# Autodesk Inventor assembly: body_plus_tail
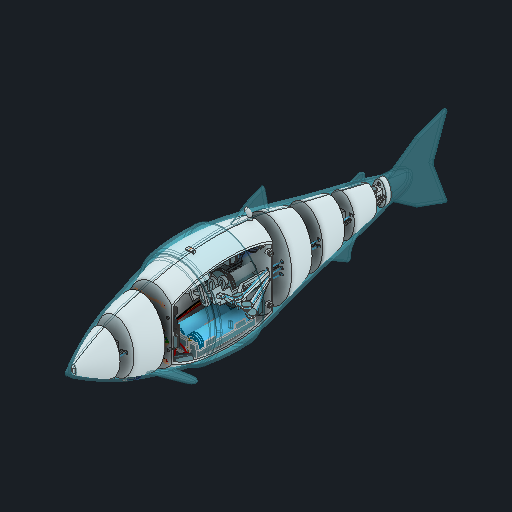
[picture p0: Inventor's stored thumbnail of the model, 512x512]
Saved by Autodesk Inventor 2026.1 (Build 301233020, 233B)
## iProperties
Created: 2025-11-26
Part Number: body_plus_tail
Document SubType Name: Assembly
Designer: maxbu
Author: maxbu
## Documents named in this file (50)
- C:\Users\caldi\Desktop\Magistrale\02_SECONDO ANNO\BIOINSPIRED ROBOTICS\PROJECT\3D_MODEL\B1_Fish_assembly.iam
- C:\Users\caldi\Desktop\Magistrale\02_SECONDO ANNO\BIOINSPIRED ROBOTICS\PROJECT\3D_MODEL\body.ipt
- C:\Users\caldi\Desktop\Magistrale\02_SECONDO ANNO\BIOINSPIRED ROBOTICS\PROJECT\3D_MODEL\wheel.ipt
- C:\Users\caldi\Desktop\Magistrale\02_SECONDO ANNO\BIOINSPIRED ROBOTICS\PROJECT\3D_MODEL\rod.ipt
- C:\Users\caldi\Desktop\Magistrale\02_SECONDO ANNO\BIOINSPIRED ROBOTICS\PROJECT\3D_MODEL\motor.ipt
- C:\Users\caldi\Desktop\Magistrale\02_SECONDO ANNO\BIOINSPIRED ROBOTICS\PROJECT\3D_MODEL\motor_gear.ipt
- C:\Users\caldi\Desktop\Magistrale\02_SECONDO ANNO\BIOINSPIRED ROBOTICS\PROJECT\3D_MODEL\pulley.ipt
- C:\Users\caldi\Desktop\Magistrale\02_SECONDO ANNO\BIOINSPIRED ROBOTICS\PROJECT\3D_MODEL\D_WIRES\wire1.ipt
- C:\Users\caldi\Desktop\Magistrale\02_SECONDO ANNO\BIOINSPIRED ROBOTICS\PROJECT\3D_MODEL\tail_segment_1.ipt
- C:\Users\caldi\Desktop\Magistrale\02_SECONDO ANNO\BIOINSPIRED ROBOTICS\PROJECT\3D_MODEL\tail_segment_2.ipt
- C:\Users\caldi\Desktop\Magistrale\02_SECONDO ANNO\BIOINSPIRED ROBOTICS\PROJECT\3D_MODEL\tail_segment_3.ipt
- C:\Users\caldi\Desktop\Magistrale\02_SECONDO ANNO\BIOINSPIRED ROBOTICS\PROJECT\3D_MODEL\tail_end_plate.ipt
- C:\Users\caldi\Desktop\Magistrale\02_SECONDO ANNO\BIOINSPIRED ROBOTICS\PROJECT\3D_MODEL\D_WIRES\wire3.ipt
- C:\Users\caldi\Desktop\Magistrale\02_SECONDO ANNO\BIOINSPIRED ROBOTICS\PROJECT\3D_MODEL\D_WIRES\wire3_aaaaa.ipt
- C:\Users\caldi\Desktop\Magistrale\02_SECONDO ANNO\BIOINSPIRED ROBOTICS\PROJECT\3D_MODEL\D_WIRES\wire4.ipt
- C:\Users\caldi\Desktop\Magistrale\02_SECONDO ANNO\BIOINSPIRED ROBOTICS\PROJECT\3D_MODEL\servo_motor.ipt
- C:\Users\caldi\Desktop\Magistrale\02_SECONDO ANNO\BIOINSPIRED ROBOTICS\PROJECT\3D_MODEL\spool.ipt
- C:\Users\caldi\Desktop\Magistrale\02_SECONDO ANNO\BIOINSPIRED ROBOTICS\PROJECT\3D_MODEL\D_WIRES\wire_servo.ipt
- C:\Users\caldi\Desktop\Magistrale\02_SECONDO ANNO\BIOINSPIRED ROBOTICS\PROJECT\3D_MODEL\servo_winding.ipt
- C:\Users\caldi\Desktop\Magistrale\02_SECONDO ANNO\BIOINSPIRED ROBOTICS\PROJECT\3D_MODEL\head_segment_2.ipt
- C:\Users\caldi\Desktop\Magistrale\02_SECONDO ANNO\BIOINSPIRED ROBOTICS\PROJECT\3D_MODEL\head_segment_1.ipt
- C:\Users\caldi\Desktop\Magistrale\02_SECONDO ANNO\BIOINSPIRED ROBOTICS\PROJECT\3D_MODEL\D_WIRES\wire2_1.ipt
- C:\Users\caldi\Desktop\Magistrale\02_SECONDO ANNO\BIOINSPIRED ROBOTICS\PROJECT\3D_MODEL\D_WIRES\wire2_2.ipt
- C:\Users\caldi\Desktop\Magistrale\02_SECONDO ANNO\BIOINSPIRED ROBOTICS\PROJECT\3D_MODEL\D_WIRES\wire2_3.ipt
- C:\Users\caldi\Desktop\Magistrale\02_SECONDO ANNO\BIOINSPIRED ROBOTICS\PROJECT\3D_MODEL\C_BatteryHolder3S\BatteryHolder3S.iam
- C:\Users\caldi\Desktop\Magistrale\02_SECONDO ANNO\BIOINSPIRED ROBOTICS\PROJECT\3D_MODEL\piston.ipt
- C:\Users\caldi\Desktop\Magistrale\02_SECONDO ANNO\BIOINSPIRED ROBOTICS\PROJECT\3D_MODEL\worm_gear.ipt
- C:\Users\caldi\Desktop\Magistrale\02_SECONDO ANNO\BIOINSPIRED ROBOTICS\PROJECT\3D_MODEL\piston_motor.ipt
- C:\Users\caldi\Desktop\Magistrale\02_SECONDO ANNO\BIOINSPIRED ROBOTICS\PROJECT\3D_MODEL\B_Sensors\BAR30-ASM-R2-PUBLIC\BAR30-ASM-R2-PUBLIC.ipt
- C:\Users\caldi\Desktop\Magistrale\02_SECONDO ANNO\BIOINSPIRED ROBOTICS\PROJECT\3D_MODEL\cylinder.ipt
- C:\Users\caldi\Desktop\Magistrale\02_SECONDO ANNO\BIOINSPIRED ROBOTICS\PROJECT\3D_MODEL\cylinder_head.ipt
- C:\Users\caldi\Desktop\Magistrale\02_SECONDO ANNO\BIOINSPIRED ROBOTICS\PROJECT\3D_MODEL\oring.ipt
- C:\Users\caldi\Desktop\Magistrale\02_SECONDO ANNO\BIOINSPIRED ROBOTICS\PROJECT\3D_MODEL\B_Sensors\Controllore_esp32-c6.ipt
- C:\Users\caldi\Desktop\Magistrale\02_SECONDO ANNO\BIOINSPIRED ROBOTICS\PROJECT\3D_MODEL\tail_end_for_animation.ipt
- C:\Users\caldi\Desktop\Magistrale\02_SECONDO ANNO\BIOINSPIRED ROBOTICS\PROJECT\3D_MODEL\cuscinetto_wheel.ipt
- C:\Users\caldi\Desktop\Magistrale\02_SECONDO ANNO\BIOINSPIRED ROBOTICS\PROJECT\3D_MODEL\ISO 1580 - M3 x 5_.ipt
- C:\Users\caldi\Desktop\Magistrale\02_SECONDO ANNO\BIOINSPIRED ROBOTICS\PROJECT\3D_MODEL\perni.ipt
- C:\Users\caldi\Desktop\Magistrale\02_SECONDO ANNO\BIOINSPIRED ROBOTICS\PROJECT\3D_MODEL\BS 3673_1 - S005M.ipt
- C:\Users\caldi\Desktop\Magistrale\02_SECONDO ANNO\BIOINSPIRED ROBOTICS\PROJECT\3D_MODEL\spring.ipt
- C:\Users\caldi\Desktop\Magistrale\02_SECONDO ANNO\BIOINSPIRED ROBOTICS\PROJECT\3D_MODEL\spring2.ipt
- C:\Users\caldi\Desktop\Magistrale\02_SECONDO ANNO\BIOINSPIRED ROBOTICS\PROJECT\3D_MODEL\tail_end_silicon.ipt
- C:\Users\caldi\Desktop\Magistrale\02_SECONDO ANNO\BIOINSPIRED ROBOTICS\PROJECT\3D_MODEL\silicon_skin.ipt
- C:\Users\caldi\Desktop\Magistrale\02_SECONDO ANNO\BIOINSPIRED ROBOTICS\PROJECT\3D_MODEL\Body_cover.ipt
- C:\Users\caldi\Desktop\Magistrale\02_SECONDO ANNO\BIOINSPIRED ROBOTICS\PROJECT\3D_MODEL\B_Sensors\sensoreTDS.ipt
- C:\Users\caldi\Desktop\Magistrale\02_SECONDO ANNO\BIOINSPIRED ROBOTICS\PROJECT\3D_MODEL\B_Sensors\pcb_TDS_sensor.ipt
- C:\Users\caldi\Desktop\Magistrale\02_SECONDO ANNO\BIOINSPIRED ROBOTICS\PROJECT\3D_MODEL\weight.ipt
- C:\Users\caldi\Desktop\Magistrale\02_SECONDO ANNO\BIOINSPIRED ROBOTICS\PROJECT\3D_MODEL\B_Sensors\MPU6050 Accelerometer_1.ipt
- C:\Users\caldi\Desktop\Magistrale\02_SECONDO ANNO\BIOINSPIRED ROBOTICS\PROJECT\3D_MODEL\B_Sensors\sensore_Temp.ipt
- C:\Users\caldi\Desktop\Magistrale\02_SECONDO ANNO\BIOINSPIRED ROBOTICS\PROJECT\3D_MODEL\viti_iso_2010-m2x10.ipt
- C:\Users\caldi\Desktop\Magistrale\02_SECONDO ANNO\BIOINSPIRED ROBOTICS\PROJECT\3D_MODEL\E_Cavi e cablaggi\Cablaggio1.iam
## Components (148 placed, 49 different names)
1. tail_end_silicon:1 — Flush:4, Flush:5, Flush:6
2. tail_end_for_animation:1 — Mate:122, Mate:123, Mate:124
3. silicon_skin:1 — Flush:7, Flush:8, Flush:9
4. viti_iso_2010-m2x10:1 — Mate:242, Mate:243
5. viti_iso_2010-m2x10:2 — Mate:244, Mate:245
6. Cablaggio1:1 [sub-assembly] — Mate:246
7. body:1 — Mate:1, Mate:2, Mate:4, Mate:5, Mate:8, Flush:1, Mate:18, Mate:19, Mate:20, Mate:21, Mate:25, Mate:26, Angle:1, Angle:2, Angle:3, Angle:4, Angle:5, Mate:37, Mate:38, Mate:39, Ball:15, Ball:16, Mate:42, Mate:43, Angle:8, Angle:9, Angle:10, Mate:50, Mate:51, Mate:52, Mate:53, Mate:54, Mate:55, Mate:57, Mate:58, Mate:59, Mate:60, Mate:68, Mate:69, Mate:72, Mate:73, Ball:26, Mate:97, Mate:98, Mate:99, Mate:102, Mate:103, Angle:11, Mate:113, Mate:114, Mate:115, Mate:120, Mate:121, Mate:125, Mate:146, Mate:168, Mate:169, Mate:176, Tangent:9, Mate:179, Tangent:10, Flush:4, Flush:5, Flush:6, Flush:7, Flush:8, Flush:9, Mate:200, Mate:201, Mate:202, Mate:203, Mate:205, Mate:207, Mate:212, Mate:213, Mate:214, Mate:215, Mate:216, Mate:217, Mate:218, Mate:219, Mate:221, Mate:222, Mate:223, Mate:224, Mate:226, Mate:230, Tangent:17, Mate:231, Tangent:18
8. Body_cover:1 — Mate:200, Mate:201, Mate:202, Mate:204, Mate:206, Mate:208
9. BatteryHolder3S:1 [sub-assembly] — Mate:97, Mate:98, Mate:99, Mate:144, Mate:145, Mate:147, Mate:246
10. Controllore_esp32-c6:1 — Mate:102, Mate:103, Angle:11, Mate:172, Mate:173
11. pcb_TDS_sensor:1 — Mate:212, Mate:213, Mate:214
12. MPU6050 Accelerometer_1:1 — Mate:221, Mate:222, Mate:223, Mate:225, Mate:227
13. weight:1
14. weight:2
15. weight:3
16. weight:4 — Mate:219, Mate:220, Flush:10, Flush:11
17. weight:5 — Mate:220, Flush:10, Flush:11
18. tail_end_plate:1 — Mate:31, Mate:32, Angle:5, Mate:122, Mate:123, Mate:124, Mate:166, Mate:167, Mate:194, Mate:195, Mate:242, Mate:243, Mate:244, Mate:245
19. perni:4 — Mate:160, Mate:161, Mate:166, Mate:167
20. BS 3673 : Parte 1 - Metrico S005M:6 — Mate:160, Mate:161
21. spring:8 — Mate:187, Tangent:16, Mate:199
22. spring:9 — Mate:186, Tangent:15, Mate:198
23. spring2:7 — Mate:194, Mate:199
24. spring2:8 — Mate:195, Mate:198
25. head_segment_2:1 — Mate:42, Mate:43, Angle:8, Mate:44, Mate:45, Ball:19, Ball:20, Ball:21, Ball:23, Mate:170, Mate:171, Mate:174, Mate:175, Mate:209, Mate:210, Mate:228, Mate:229, Mate:232, Mate:234, Mate:236, Tangent:19, Mate:237, Tangent:20
26. head_segment_1:1 — Mate:44, Mate:45, Angle:9, Mate:48, Mate:49, Mate:238, Mate:240
27. wire3:7 — Cylindrical:9, Ball:22
28. wire3:8 — Cylindrical:10, Ball:24
29. wire4:3 — Mate:49, Cylindrical:8
30. wire4:4 — Mate:48, Cylindrical:7
31. wire3_aaaaa:7 — Ball:19, Cylindrical:7
32. wire3_aaaaa:8 — Ball:20, Cylindrical:8
33. wire3_aaaaa:9 — Ball:21, Cylindrical:9
34. wire3_aaaaa:10 — Ball:23, Cylindrical:10
35. spring:10 — Mate:230, Tangent:17, Mate:233
36. spring:11 — Mate:231, Tangent:18, Mate:235
37. spring2:9 — Mate:232, Mate:233
38. spring2:10 — Mate:234, Mate:235
39. spring:12 — Mate:236, Tangent:19, Mate:239
40. spring:13 — Mate:237, Tangent:20, Mate:241
41. spring2:11 — Mate:238, Mate:239
42. spring2:12 — Mate:240, Mate:241
43. perni:5 — Mate:152, Mate:153, Mate:168, Mate:169
44. perni:6 — Mate:150, Mate:151, Mate:170, Mate:171
45. BS 3673 : Parte 1 - Metrico S005M:1 — Mate:150, Mate:151
46. BS 3673 : Parte 1 - Metrico S005M:2 — Mate:152, Mate:153
47. sensoreTDS:1 — Mate:209, Mate:210
48. BAR30-ASM-R2-PUBLIC:1 — Mate:174, Mate:175
49. sensore_Temp:1 — Mate:228, Mate:229
50. motor:1 — Mate:4, Mate:5, Mate:8, Mate:9, Mate:10, Mate:139, Mate:140, Mate:141, Mate:142, Mate:143
51. motor_gear:1 — Mate:9, Mate:10, Rotation:1
52. wheel:1 — Mate:1, Mate:2, Rotation:1, Tangent:3, Angle:1, Tangent:6, Tangent:7, Mate:126
53. cuscinetto_wheel:1 — Mate:125, Mate:126
54. ISO 1580 M3 x 5:1 — Mate:142, Mate:143
55. ISO 1580 M3 x 5:4 — Mate:139, Mate:140, Mate:141
56. servo_motor:1 — Mate:35, Mate:36, Mate:37, Mate:38, Mate:39, Angle:6, Angle:7, Mate:127, Mate:128, Mate:129, Mate:130
57. servo_winding — Mate:40, Mate:41
58. wire_servo:2 — Ball:16, Tangent:5, Angle:7, Ball:24
59. wire_servo:1 — Tangent:4, Ball:15, Angle:6, Ball:22
60. spool:1 — Mate:35, Mate:36, Tangent:4, Tangent:5, Mate:40, Mate:41, Angle:10
61. ISO 1580 M3 x 5:10 — Mate:127, Mate:128
62. ISO 1580 M3 x 5:9 — Mate:129, Mate:130
63. piston_motor:1 — Mate:104, Mate:106, Mate:120, Mate:121, Mate:131, Mate:132, Mate:133, Mate:134
64. piston:1 — Mate:106, Mate:107, Mate:108, Flush:2, Mate:118, Tangent:8, Rotation/Translation:4, Mate:119, Flush:3
65. worm_gear:1 — Mate:104, Mate:112, Rotation/Translation:4
66. cylinder:1 — Mate:107, Mate:108, Mate:109, Mate:110, Mate:111, Mate:112, Flush:2, Flush:3, Mate:135, Mate:136, Mate:137, Mate:138
67. oring:1 — Mate:118, Tangent:8
68. cylinder_head:1 — Mate:109, Mate:110, Mate:111, Mate:113, Mate:114, Mate:115, Mate:119
69. ISO 1580 M3 x 5:7 — Mate:135, Mate:136
70. ISO 1580 M3 x 5:5 — Mate:137, Mate:138
71. ISO 1580 M3 x 5:6 — Mate:131, Mate:132
72. ISO 1580 M3 x 5:8 — Mate:133, Mate:134
73. ISO 1580 M3 x 5:17 — Mate:224, Mate:225
74. ISO 1580 M3 x 5:18 — Mate:226, Mate:227
75. ISO 1580 M3 x 5:2 — Mate:146, Mate:147
76. ISO 1580 M3 x 5:3 — Mate:144, Mate:145
77. ISO 1580 M3 x 5:11 — Mate:172, Mate:173
78. ISO 1580 M3 x 5:12 — Mate:203, Mate:204
79. ISO 1580 M3 x 5:13 — Mate:207, Mate:208
80. ISO 1580 M3 x 5:14 — Mate:205, Mate:206
81. ISO 1580 M3 x 5:15 — Mate:215, Mate:216
82. ISO 1580 M3 x 5:16 — Mate:217, Mate:218
83. tail_segment_1:1 — Mate:25, Mate:26, Mate:27, Mate:28, Ball:2, Ball:3, Ball:5, Ball:8, Angle:2, Ball:28, Ball:29, Mate:90, Mate:91, Ball:30, Ball:31, Mate:148, Mate:149, Mate:177, Mate:180, Mate:182, Tangent:11, Mate:183, Tangent:12
84. wire3:11 — Ball:34, Mate:94
85. wire3:12 — Ball:35, Mate:95
86. wire4:5 — Mate:90, Mate:95
87. wire4:6 — Mate:91, Mate:94
88. perni:1 — Mate:148, Mate:149, Mate:154, Mate:155
89. BS 3673 : Parte 1 - Metrico S005M:3 — Mate:154, Mate:155
90. spring:1 — Mate:176, Tangent:9, Mate:178
91. spring2:2 — Mate:177, Mate:178
92. spring:3 — Mate:179, Tangent:10, Mate:181
93. spring2:1 — Mate:180, Mate:181
94. tail_segment_2:1 — Mate:27, Mate:28, Mate:29, Mate:30, Ball:6, Ball:7, Angle:3, Ball:17, Ball:18, Mate:86, Mate:87, Mate:162, Mate:163, Mate:184, Tangent:13, Mate:185, Tangent:14, Mate:188, Mate:190
95. wire3:1 — Cylindrical:1, Ball:27
96. wire3:2 — Cylindrical:2, Ball:26
97. wire3_aaaaa:1 — Ball:2, Cylindrical:1
98. wire3_aaaaa:2 — Ball:3, Cylindrical:2
99. wire4:7 — Mate:87, Mate:88
100. wire4:8 — Mate:86, Mate:96
101. wire3_aaaaa:13 — Ball:28, Mate:96
102. wire3_aaaaa:14 — Ball:29, Mate:88
103. perni:2 — Mate:156, Mate:157, Mate:162, Mate:163
104. BS 3673 : Parte 1 - Metrico S005M:4 — Mate:156, Mate:157
105. spring:4 — Mate:183, Tangent:12, Mate:189
106. spring:5 — Mate:182, Tangent:11, Mate:191
107. spring2:3 — Mate:188, Mate:189
108. spring2:4 — Mate:190, Mate:191
109. tail_segment_3:1 — Mate:29, Mate:30, Mate:31, Mate:32, Angle:4, Mate:46, Mate:47, Mate:164, Mate:165, Mate:186, Tangent:15, Mate:187, Tangent:16, Mate:192, Mate:193
110. wire3:9 — Ball:32, Mate:92
111. wire3:10 — Ball:33, Mate:93
112. wire3:4 — Ball:5, Cylindrical:3
113. wire3:6 — Ball:8, Cylindrical:4
114. wire4:1 — Mate:46, Cylindrical:5
115. wire4:2 — Mate:47, Cylindrical:6
116. wire3_aaaaa:11 — Ball:31, Mate:92
117. wire3_aaaaa:12 — Ball:30, Mate:93
118. wire3_aaaaa:3 — Ball:6, Cylindrical:3
119. wire3_aaaaa:4 — Ball:7, Cylindrical:4
120. wire3_aaaaa:5 — Ball:17, Cylindrical:5
121. wire3_aaaaa:6 — Ball:18, Cylindrical:6
122. perni:3 — Mate:158, Mate:159, Mate:164, Mate:165
123. BS 3673 : Parte 1 - Metrico S005M:5 — Mate:158, Mate:159
124. spring:6 — Mate:185, Tangent:14, Mate:197
125. spring:7 — Mate:184, Tangent:13, Mate:196
126. spring2:5 — Mate:193, Mate:196
127. spring2:6 — Mate:192, Mate:197
128. rod:1 — Tangent:3, Mate:13, Mate:50, Mate:51, Mate:61, Rotation/Translation:3
129. wire1:1 — Mate:13, Mate:77
130. pulley:3 — Mate:57, Mate:60, Mate:74, Rotation/Translation:3, Rotation:4
131. pulley:4 — Mate:58, Mate:59, Mate:76, Rotation:4
132. wire1:3 — Mate:61, Mate:75
133. wire2_1:1 — Mate:74, Mate:75, Ball:34
134. wire2_1:2 — Mate:76, Mate:77, Ball:33
135. rod:2 — Mate:52, Mate:53, Tangent:6, Mate:56, Mate:65, Rotation/Translation:2
136. pulley:2 — Mate:20, Mate:21, Mate:80, Rotation/Translation:2, Rotation:3
137. pulley:1 — Mate:18, Mate:19, Mate:78, Rotation:3
138. wire1:2 — Mate:56, Mate:81
139. wire1:4 — Mate:65, Mate:79
140. wire2_2:2 — Mate:80, Mate:81, Ball:27
141. wire2_2:1 — Mate:78, Mate:79
142. rod:3 — Mate:54, Mate:55, Tangent:7, Mate:70, Mate:71, Rotation/Translation:1
143. pulley:5 — Mate:68, Mate:73, Mate:82, Rotation/Translation:1, Rotation:5
144. pulley:6 — Mate:69, Mate:72, Mate:84, Rotation:5
145. wire1:5 — Mate:70, Mate:83
146. wire1:6 — Mate:71, Mate:85
147. wire2_3:1 — Mate:82, Mate:83, Ball:32
148. wire2_3:2 — Mate:84, Mate:85, Ball:35
## Relationships (304: Mate 220, BallJoint 26, Tangent 18, Flush 11, Angle 11, CylindricalJoint 10, RelateRotation 4, RelateRotateTranslate 4)
- Mate:1: body:1 ↔ wheel:1
- Mate:2: body:1 ↔ wheel:1
- Mate:4: body:1 ↔ motor:1
- Mate:5: body:1 ↔ motor:1
- Mate:8: body:1 ↔ motor:1
- Mate:9: motor:1 ↔ motor_gear:1
- Mate:10: motor:1 ↔ motor_gear:1
- Rotation:1 [RelateRotation] (0.25 ul): motor_gear:1 ↔ wheel:1
- Tangent:3: wheel:1 ↔ rod:1
- Mate:13: rod:1 ↔ wire1:1
- Flush:1 (-2.5 mm): body:1
- Mate:18: body:1 ↔ pulley:1
- Mate:19: body:1 ↔ pulley:1
- Mate:20: body:1 ↔ pulley:2
- Mate:21: body:1 ↔ pulley:2
- Mate:25: body:1 ↔ tail_segment_1:1
- Mate:26: body:1 ↔ tail_segment_1:1
- Mate:27: tail_segment_1:1 ↔ tail_segment_2:1
- Mate:28: tail_segment_1:1 ↔ tail_segment_2:1
- Mate:29: tail_segment_2:1 ↔ tail_segment_3:1
- Mate:30: tail_segment_2:1 ↔ tail_segment_3:1
- Mate:31: tail_end_plate:1 ↔ tail_segment_3:1
- Mate:32: tail_end_plate:1 ↔ tail_segment_3:1
- Ball:2: tail_segment_1:1 ↔ wire3_aaaaa:1
- Cylindrical:1: wire3:1 ↔ wire3_aaaaa:1
- Ball:3: tail_segment_1:1 ↔ wire3_aaaaa:2
- Cylindrical:2: wire3:2 ↔ wire3_aaaaa:2
- Ball:5: tail_segment_1:1 ↔ wire3:4
- Ball:6: tail_segment_2:1 ↔ wire3_aaaaa:3
- Cylindrical:3: wire3:4 ↔ wire3_aaaaa:3
- Ball:7: tail_segment_2:1 ↔ wire3_aaaaa:4
- Ball:8: tail_segment_1:1 ↔ wire3:6
- Cylindrical:4: wire3:6 ↔ wire3_aaaaa:4
- Angle:1 (0 deg): body:1 ↔ wheel:1
- Angle:2 (0 deg): body:1 ↔ tail_segment_1:1
- Angle:3 (0 deg): body:1 ↔ tail_segment_2:1
- Angle:4 (0 deg): body:1 ↔ tail_segment_3:1
- Angle:5 (0 deg): body:1 ↔ tail_end_plate:1
- Mate:35: servo_motor:1 ↔ spool:1
- Mate:36: servo_motor:1 ↔ spool:1
- Mate:37: body:1 ↔ servo_motor:1
- Mate:38: body:1 ↔ servo_motor:1
- Mate:39: body:1 ↔ servo_motor:1
- Tangent:4: wire_servo:1 ↔ spool:1
- Ball:15: body:1 ↔ wire_servo:1
- Angle:6 (77 deg): servo_motor:1 ↔ wire_servo:1
- Ball:16: body:1 ↔ wire_servo:2
- Tangent:5: wire_servo:2 ↔ spool:1
- Angle:7 (99.5 deg): servo_motor:1 ↔ wire_servo:2
- Mate:40: servo_winding ↔ spool:1
- Mate:41: servo_winding ↔ spool:1
- Mate:42: body:1 ↔ head_segment_2:1
- Mate:43: body:1 ↔ head_segment_2:1
- Angle:8 (0 deg): body:1 ↔ head_segment_2:1
- Mate:44: head_segment_2:1 ↔ head_segment_1:1
- Mate:45: head_segment_2:1 ↔ head_segment_1:1
- Angle:9 (0 deg): body:1 ↔ head_segment_1:1
- Angle:10 (0 deg): body:1 ↔ spool:1
- Mate:46: tail_segment_3:1 ↔ wire4:1
- Ball:17: tail_segment_2:1 ↔ wire3_aaaaa:5
- Cylindrical:5: wire4:1 ↔ wire3_aaaaa:5
- Mate:47: tail_segment_3:1 ↔ wire4:2
- Ball:18: tail_segment_2:1 ↔ wire3_aaaaa:6
- Cylindrical:6: wire4:2 ↔ wire3_aaaaa:6
- Mate:48: head_segment_1:1 ↔ wire4:4
- Mate:49: head_segment_1:1 ↔ wire4:3
- Ball:19: head_segment_2:1 ↔ wire3_aaaaa:7
- Cylindrical:7: wire4:4 ↔ wire3_aaaaa:7
- Ball:20: head_segment_2:1 ↔ wire3_aaaaa:8
- Cylindrical:8: wire4:3 ↔ wire3_aaaaa:8
- Ball:21: head_segment_2:1 ↔ wire3_aaaaa:9
- Cylindrical:9: wire3:7 ↔ wire3_aaaaa:9
- Ball:22: wire3:7 ↔ wire_servo:1
- Ball:23: head_segment_2:1 ↔ wire3_aaaaa:10
- Cylindrical:10: wire3:8 ↔ wire3_aaaaa:10
- Ball:24: wire3:8 ↔ wire_servo:2
- Mate:50: body:1 ↔ rod:1
- Mate:51: body:1 ↔ rod:1
- Mate:52: body:1 ↔ rod:2
- Mate:53: body:1 ↔ rod:2
- Tangent:6: wheel:1 ↔ rod:2
- Mate:54: body:1 ↔ rod:3
- Mate:55: body:1 ↔ rod:3
- Tangent:7: wheel:1 ↔ rod:3
- Mate:56: rod:2 ↔ wire1:2
- Mate:57: body:1 ↔ pulley:3
- Mate:58: body:1 ↔ pulley:4
- Mate:59: body:1 ↔ pulley:4
- Mate:60: body:1 ↔ pulley:3
- Mate:61: rod:1 ↔ wire1:3
- Mate:65: rod:2 ↔ wire1:4
- Mate:68: body:1 ↔ pulley:5
- Mate:69: body:1 ↔ pulley:6
- Mate:70: rod:3 ↔ wire1:5
- Mate:71: rod:3 ↔ wire1:6
- Mate:72: body:1 ↔ pulley:6
- Mate:73: body:1 ↔ pulley:5
- Ball:26: body:1 ↔ wire3:2
- Mate:74: pulley:3 ↔ wire2_1:1
- Mate:75: wire1:3 ↔ wire2_1:1
- Mate:76: pulley:4 ↔ wire2_1:2
- Mate:77: wire1:1 ↔ wire2_1:2
- Mate:78: pulley:1 ↔ wire2_2:1
- Mate:79: wire1:4 ↔ wire2_2:1
- Mate:80: pulley:2 ↔ wire2_2:2
- Mate:81: wire1:2 ↔ wire2_2:2
- Mate:82: pulley:5 ↔ wire2_3:1
- Mate:83: wire1:5 ↔ wire2_3:1
- Mate:84: pulley:6 ↔ wire2_3:2
- Mate:85: wire1:6 ↔ wire2_3:2
- Ball:27: wire3:1 ↔ wire2_2:2
- Rotation/Translation:1 [RelateRotateTranslate] (25 mm): rod:3 ↔ pulley:5
- Rotation/Translation:2 [RelateRotateTranslate] (25 mm): rod:2 ↔ pulley:2
- Rotation/Translation:3 [RelateRotateTranslate] (25 mm): rod:1 ↔ pulley:3
- Rotation:3 [RelateRotation] (1 ul): pulley:2 ↔ pulley:1
- Rotation:4 [RelateRotation] (1 ul): pulley:3 ↔ pulley:4
- Rotation:5 [RelateRotation] (1 ul): pulley:5 ↔ pulley:6
- Mate:86: tail_segment_2:1 ↔ wire4:8
- Ball:28: tail_segment_1:1 ↔ wire3_aaaaa:13
- Ball:29: tail_segment_1:1 ↔ wire3_aaaaa:14
- Mate:87: tail_segment_2:1 ↔ wire4:7
- Mate:88: wire4:7 ↔ wire3_aaaaa:14
- Mate:90: tail_segment_1:1 ↔ wire4:5
- Mate:91: tail_segment_1:1 ↔ wire4:6
- Ball:30: tail_segment_1:1 ↔ wire3_aaaaa:12
- Ball:31: tail_segment_1:1 ↔ wire3_aaaaa:11
- Ball:32: wire3:9 ↔ wire2_3:1
- Ball:33: wire3:10 ↔ wire2_1:2
- Mate:92: wire3:9 ↔ wire3_aaaaa:11
- Mate:93: wire3:10 ↔ wire3_aaaaa:12
- Ball:34: wire3:11 ↔ wire2_1:1
- Ball:35: wire3:12 ↔ wire2_3:2
- Mate:94: wire3:11 ↔ wire4:6
- Mate:95: wire3:12 ↔ wire4:5
- Mate:96: wire4:8 ↔ wire3_aaaaa:13
- Mate:97: body:1 ↔ BatteryHolder3S:1
- Mate:98: body:1 ↔ BatteryHolder3S:1
- Mate:99: body:1 ↔ BatteryHolder3S:1
- Mate:102: body:1 ↔ Controllore_esp32-c6:1
- Mate:103: body:1 ↔ Controllore_esp32-c6:1
- Angle:11 (0 deg): body:1 ↔ Controllore_esp32-c6:1
- Mate:104: piston_motor:1 ↔ worm_gear:1
- Mate:106: piston_motor:1 ↔ piston:1
- Mate:107: piston:1 ↔ cylinder:1
- Mate:108: piston:1 ↔ cylinder:1
- Mate:109: cylinder:1 ↔ cylinder_head:1
- Mate:110: cylinder:1 ↔ cylinder_head:1
- Mate:111: cylinder:1 ↔ cylinder_head:1
- Mate:112: worm_gear:1 ↔ cylinder:1
- Flush:2 (-20 mm): piston:1 ↔ cylinder:1
- Mate:113: body:1 ↔ cylinder_head:1
- Mate:114: body:1 ↔ cylinder_head:1
- Mate:115: body:1 ↔ cylinder_head:1
- Mate:118: piston:1 ↔ oring:1
- Tangent:8: piston:1 ↔ oring:1
- Rotation/Translation:4 [RelateRotateTranslate] (2 mm): piston:1 ↔ worm_gear:1
- Mate:119: piston:1 ↔ cylinder_head:1
- Mate:120: body:1 ↔ piston_motor:1
- Mate:121: body:1 ↔ piston_motor:1
- Flush:3 (38 mm): piston:1 ↔ cylinder:1
- Mate:122: tail_end_for_animation:1 ↔ tail_end_plate:1
- Mate:123: tail_end_for_animation:1 ↔ tail_end_plate:1
- Mate:124: tail_end_for_animation:1 ↔ tail_end_plate:1
- Mate:125: body:1 ↔ cuscinetto_wheel:1
- Mate:126: wheel:1 ↔ cuscinetto_wheel:1
- Mate:127: servo_motor:1 ↔ ISO 1580 M3 x 5:10
- Mate:128: servo_motor:1 ↔ ISO 1580 M3 x 5:10
- Mate:129: servo_motor:1 ↔ ISO 1580 M3 x 5:9
- Mate:130: servo_motor:1 ↔ ISO 1580 M3 x 5:9
- Mate:131: piston_motor:1 ↔ ISO 1580 M3 x 5:6
- Mate:132: piston_motor:1 ↔ ISO 1580 M3 x 5:6
- Mate:133: piston_motor:1 ↔ ISO 1580 M3 x 5:8
- Mate:134: piston_motor:1 ↔ ISO 1580 M3 x 5:8
- Mate:135: cylinder:1 ↔ ISO 1580 M3 x 5:7
- Mate:136: cylinder:1 ↔ ISO 1580 M3 x 5:7
- Mate:137: cylinder:1 ↔ ISO 1580 M3 x 5:5
- Mate:138: cylinder:1 ↔ ISO 1580 M3 x 5:5
- Mate:139: motor:1 ↔ ISO 1580 M3 x 5:4
- Mate:140: motor:1 ↔ ISO 1580 M3 x 5:4
- Mate:141: motor:1 ↔ ISO 1580 M3 x 5:4
- Mate:142: motor:1 ↔ ISO 1580 M3 x 5:1
- Mate:143: motor:1 ↔ ISO 1580 M3 x 5:1
- Mate:144: BatteryHolder3S:1 ↔ ISO 1580 M3 x 5:3
- Mate:145: BatteryHolder3S:1 ↔ ISO 1580 M3 x 5:3
- Mate:146: body:1 ↔ ISO 1580 M3 x 5:2
- Mate:147: BatteryHolder3S:1 ↔ ISO 1580 M3 x 5:2
- Mate:148: tail_segment_1:1 ↔ perni:1
- Mate:149: tail_segment_1:1 ↔ perni:1
- Mate:150: perni:6 ↔ BS 3673 : Parte 1 - Metrico S005M:1
- Mate:151: perni:6 ↔ BS 3673 : Parte 1 - Metrico S005M:1
- Mate:152: perni:5 ↔ BS 3673 : Parte 1 - Metrico S005M:2
- Mate:153: perni:5 ↔ BS 3673 : Parte 1 - Metrico S005M:2
- Mate:154: perni:1 ↔ BS 3673 : Parte 1 - Metrico S005M:3
- Mate:155: perni:1 ↔ BS 3673 : Parte 1 - Metrico S005M:3
- Mate:156: perni:2 ↔ BS 3673 : Parte 1 - Metrico S005M:4
- Mate:157: perni:2 ↔ BS 3673 : Parte 1 - Metrico S005M:4
- Mate:158: perni:3 ↔ BS 3673 : Parte 1 - Metrico S005M:5
- Mate:159: perni:3 ↔ BS 3673 : Parte 1 - Metrico S005M:5
- Mate:160: perni:4 ↔ BS 3673 : Parte 1 - Metrico S005M:6
- Mate:161: perni:4 ↔ BS 3673 : Parte 1 - Metrico S005M:6
- Mate:162: tail_segment_2:1 ↔ perni:2
- Mate:163: tail_segment_2:1 ↔ perni:2
- Mate:164: tail_segment_3:1 ↔ perni:3
- Mate:165: tail_segment_3:1 ↔ perni:3
- Mate:166: tail_end_plate:1 ↔ perni:4
- Mate:167: tail_end_plate:1 ↔ perni:4
- Mate:168: body:1 ↔ perni:5
- Mate:169: body:1 ↔ perni:5
- Mate:170: head_segment_2:1 ↔ perni:6
- Mate:171: head_segment_2:1 ↔ perni:6
- Mate:172: Controllore_esp32-c6:1 ↔ ISO 1580 M3 x 5:11
- Mate:173: Controllore_esp32-c6:1 ↔ ISO 1580 M3 x 5:11
- Mate:174: head_segment_2:1 ↔ BAR30-ASM-R2-PUBLIC:1
- Mate:175: head_segment_2:1 ↔ BAR30-ASM-R2-PUBLIC:1
- Mate:176: body:1 ↔ spring:1
- Tangent:9: body:1 ↔ spring:1
- Mate:177: tail_segment_1:1 ↔ spring2:2
- Mate:178: spring:1 ↔ spring2:2
- Mate:179: body:1 ↔ spring:3
- Tangent:10: body:1 ↔ spring:3
- Mate:180: tail_segment_1:1 ↔ spring2:1
- Mate:181: spring:3 ↔ spring2:1
- Mate:182: tail_segment_1:1 ↔ spring:5
- Tangent:11: tail_segment_1:1 ↔ spring:5
- Mate:183: tail_segment_1:1 ↔ spring:4
- Tangent:12: tail_segment_1:1 ↔ spring:4
- Mate:184: tail_segment_2:1 ↔ spring:7
- Tangent:13: tail_segment_2:1 ↔ spring:7
- Mate:185: tail_segment_2:1 ↔ spring:6
- Tangent:14: tail_segment_2:1 ↔ spring:6
- Mate:186: spring:9 ↔ tail_segment_3:1
- Tangent:15: spring:9 ↔ tail_segment_3:1
- Mate:187: spring:8 ↔ tail_segment_3:1
- Tangent:16: spring:8 ↔ tail_segment_3:1
- Mate:188: tail_segment_2:1 ↔ spring2:3
- Mate:189: spring:4 ↔ spring2:3
- Mate:190: tail_segment_2:1 ↔ spring2:4
- Mate:191: spring:5 ↔ spring2:4
- Mate:192: tail_segment_3:1 ↔ spring2:6
- Mate:193: tail_segment_3:1 ↔ spring2:5
- Mate:194: tail_end_plate:1 ↔ spring2:7
- Mate:195: tail_end_plate:1 ↔ spring2:8
- Mate:196: spring:7 ↔ spring2:5
- Mate:197: spring:6 ↔ spring2:6
- Mate:198: spring:9 ↔ spring2:8
- Mate:199: spring:8 ↔ spring2:7
- Flush:4: tail_end_silicon:1 ↔ body:1
- Flush:5: tail_end_silicon:1 ↔ body:1
- Flush:6 (300 mm): tail_end_silicon:1 ↔ body:1
- Flush:7: silicon_skin:1 ↔ body:1
- Flush:8: silicon_skin:1 ↔ body:1
- Flush:9 (-98.5 mm): silicon_skin:1 ↔ body:1
- Mate:200: body:1 ↔ Body_cover:1
- Mate:201: body:1 ↔ Body_cover:1
- Mate:202: body:1 ↔ Body_cover:1
- Mate:203: body:1 ↔ ISO 1580 M3 x 5:12
- Mate:204: Body_cover:1 ↔ ISO 1580 M3 x 5:12
- Mate:205: body:1 ↔ ISO 1580 M3 x 5:14
- Mate:206: Body_cover:1 ↔ ISO 1580 M3 x 5:14
- Mate:207: body:1 ↔ ISO 1580 M3 x 5:13
- Mate:208: Body_cover:1 ↔ ISO 1580 M3 x 5:13
- Mate:209: head_segment_2:1 ↔ sensoreTDS:1
- Mate:210: head_segment_2:1 ↔ sensoreTDS:1
- Mate:212: body:1 ↔ pcb_TDS_sensor:1
- Mate:213: body:1 ↔ pcb_TDS_sensor:1
- Mate:214: body:1 ↔ pcb_TDS_sensor:1
- Mate:215: body:1 ↔ ISO 1580 M3 x 5:15
- Mate:216: body:1 ↔ ISO 1580 M3 x 5:15
- Mate:217: body:1 ↔ ISO 1580 M3 x 5:16
- Mate:218: body:1 ↔ ISO 1580 M3 x 5:16
- Mate:219: body:1 ↔ weight:4
- Mate:220: weight:4 ↔ weight:5
- Flush:10: weight:4 ↔ weight:5
- Flush:11: weight:4 ↔ weight:5
- Mate:221: body:1 ↔ MPU6050 Accelerometer_1:1
- Mate:222: body:1 ↔ MPU6050 Accelerometer_1:1
- Mate:223: body:1 ↔ MPU6050 Accelerometer_1:1
- Mate:224: body:1 ↔ ISO 1580 M3 x 5:17
- Mate:225: MPU6050 Accelerometer_1:1 ↔ ISO 1580 M3 x 5:17
- Mate:226: body:1 ↔ ISO 1580 M3 x 5:18
- Mate:227: MPU6050 Accelerometer_1:1 ↔ ISO 1580 M3 x 5:18
- Mate:228: head_segment_2:1 ↔ sensore_Temp:1
- Mate:229: head_segment_2:1 ↔ sensore_Temp:1
- Mate:230: body:1 ↔ spring:10
- Tangent:17: body:1 ↔ spring:10
- Mate:231: body:1 ↔ spring:11
- Tangent:18: body:1 ↔ spring:11
- Mate:232: head_segment_2:1 ↔ spring2:9
- Mate:233: spring:10 ↔ spring2:9
- Mate:234: head_segment_2:1 ↔ spring2:10
- Mate:235: spring:11 ↔ spring2:10
- Mate:236: head_segment_2:1 ↔ spring:12
- Tangent:19: head_segment_2:1 ↔ spring:12
- Mate:237: head_segment_2:1 ↔ spring:13
- Tangent:20: head_segment_2:1 ↔ spring:13
- Mate:238: head_segment_1:1 ↔ spring2:11
- Mate:239: spring:12 ↔ spring2:11
- Mate:240: head_segment_1:1 ↔ spring2:12
- Mate:241: spring:13 ↔ spring2:12
- Mate:242: viti_iso_2010-m2x10:1 ↔ tail_end_plate:1
- Mate:243: viti_iso_2010-m2x10:1 ↔ tail_end_plate:1
- Mate:244: viti_iso_2010-m2x10:2 ↔ tail_end_plate:1
- Mate:245: viti_iso_2010-m2x10:2 ↔ tail_end_plate:1
- Mate:246: Cablaggio1:1 ↔ BatteryHolder3S:1
## Named parameters: theta = 0 deg, theta_link1 = 0 deg, phase = 0 deg, phase_head = -30 deg, head_on_off = 0, Finish2_Area = 69.4573, Finish3_Area = 103.694, Finish4_Area = 59.6462
note: some values were not read from the file. Shown as the stored number, unit unknown: "Finish2_Area", "Finish3_Area", "Finish4_Area".
